# Autodesk Inventor assembly: 2020 FootEnd
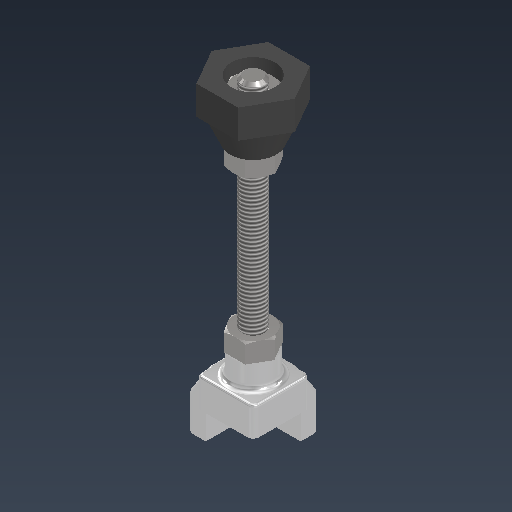
[picture p0: Inventor's stored thumbnail of the model, 512x512]
Saved by Autodesk Inventor 2026.2 (Build 302298010, 298A)
## iProperties
Created: 2026-05-13
Part Number: 2020 FootEnd
Document SubType Name: Assembly
Designer: khw
Author: khw
## Documents named in this file (5)
- C:\Users\khw\Desktop\ARD_v1\ARD_hardware\Common Objects\Profile\2020FootEnd\2020 FootEnd.iam
- C:\Users\khw\Desktop\ARD_v1\ARD_hardware\Common Objects\Profile\2020FootEnd\2020 FootEnd_FOOT.ipt
- C:\Users\khw\Desktop\ARD_v1\ARD_hardware\Common Objects\Profile\2020FootEnd\2020 FootEnd_t8.ipt
- C:\Users\khw\Desktop\ARD_v1\ARD_hardware\Common Objects\Profile\2020FootEnd\2020 FootEnd.ipt
- C:\Users\khw\Desktop\ARD_v1\ARD_hardware\Common Objects\Profile\2020FootEnd\JIS B 1181 - M8(6).ipt
## Components (6 placed, 4 different names)
1. 2020 FootEnd_FOOT:1 — 메이트:1, 플러쉬:2, 삽입:1, 삽입:3
2. 2020 FootEnd_t8:1 — 메이트:1, 메이트:2, 플러쉬:1, 플러쉬:2
3. 2020 FootEnd:1 — 메이트:2, 플러쉬:1, 삽입:2
4. JIS B 1181 - M8(6):1 — 삽입:1
5. JIS B 1181 - M8(6):2 — 삽입:2
6. JIS B 1181 - M8(6):3 — 삽입:3
## Relationships (7: Insert 3, Mate 2, Flush 2)
- 메이트:1 [Mate]: 2020 FootEnd_FOOT:1 ↔ 2020 FootEnd_t8:1
- 메이트:2 [Mate]: 2020 FootEnd_t8:1 ↔ 2020 FootEnd:1
- 플러쉬:1 [Flush]: 2020 FootEnd_t8:1 ↔ 2020 FootEnd:1
- 플러쉬:2 [Flush]: 2020 FootEnd_FOOT:1 ↔ 2020 FootEnd_t8:1
- 삽입:1 [Insert]: 2020 FootEnd_FOOT:1 ↔ JIS B 1181 - M8(6):1
- 삽입:2 [Insert]: 2020 FootEnd:1 ↔ JIS B 1181 - M8(6):2
- 삽입:3 [Insert]: 2020 FootEnd_FOOT:1 ↔ JIS B 1181 - M8(6):3
